# Autodesk Inventor assembly: assemblage_U_support
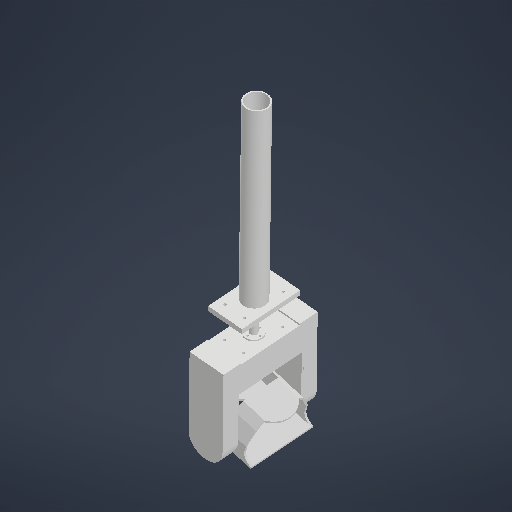
[picture p0: Inventor's stored thumbnail of the model, 512x512]
Saved by Autodesk Inventor 2026.1 (Build 301233020, 233B)
## iProperties
Created: 2026-11-17
Part Number: assemblage_U_support
Document SubType Name: Assembly
Designer: matar
Author: matar
## Documents named in this file (6)
- C:\Users\matar\OneDrive - ENSTA\ROB_3A\Camacou\assemblage_U_support.iam
- C:\Users\matar\OneDrive - ENSTA\ROB_3A\Camacou\U_support.ipt
- C:\Users\matar\OneDrive - ENSTA\ROB_3A\Camacou\support_camacou.ipt
- C:\Users\matar\OneDrive - ENSTA\ROB_3A\Camacou\bras_exterieur.ipt
- C:\Users\matar\OneDrive - ENSTA\ROB_3A\Camacou\bras_intérieur_tige.ipt
- C:\Users\matar\OneDrive - ENSTA\ROB_3A\Camacou\lien_arbre_exterieur_U.ipt
## Components (5 placed, 5 different names)
1. U_support:1 — Mate:1, Mate:2, Mate:4, Mate:6, Mate:9, Mate:10
2. support_camacou:1 — Mate:1, Mate:4
3. bras_exterieur:1 — Mate:2, Mate:5, Mate:7, Mate:8
4. bras_intérieur_tige:1 — Mate:5, Mate:6, Mate:10
5. lien_arbre_exterieur_U:1 — Mate:7, Mate:8, Mate:9
## Relationships (9: Mate 9)
- Mate:1: U_support:1 ↔ support_camacou:1
- Mate:2: U_support:1 ↔ bras_exterieur:1
- Mate:4: U_support:1 ↔ support_camacou:1
- Mate:5: bras_exterieur:1 ↔ bras_intérieur_tige:1
- Mate:6: U_support:1 ↔ bras_intérieur_tige:1
- Mate:7: bras_exterieur:1 ↔ lien_arbre_exterieur_U:1
- Mate:8: bras_exterieur:1 ↔ lien_arbre_exterieur_U:1
- Mate:9: U_support:1 ↔ lien_arbre_exterieur_U:1
- Mate:10: U_support:1 ↔ bras_intérieur_tige:1
